# Autodesk Inventor assembly: potmeter
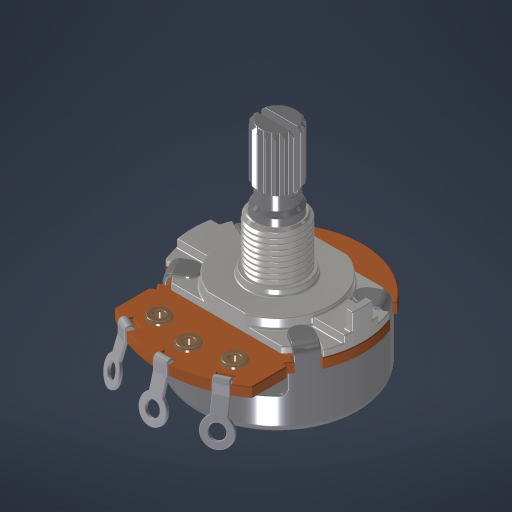
[picture p0: Inventor's stored thumbnail of the model, 512x512]
Saved by Autodesk Inventor 2023 (Build 270158000, 158)
## iProperties
Created: 2015-06-22
Part Number: potmeter
Document SubType Name: Assembly
Designer: Peter Mulkers
Author: Peter Mulkers
## Documents named in this file (10)
- D:\Folder Instalacyjny\GitHub Pliki\HOTAS\Inventor\Pot\potmeter.iam
- D:\Folder Instalacyjny\GitHub Pliki\HOTAS\Inventor\Pot\base.ipt
- D:\Folder Instalacyjny\GitHub Pliki\HOTAS\Inventor\Pot\casing.ipt
- D:\Folder Instalacyjny\GitHub Pliki\HOTAS\Inventor\Pot\revet.ipt
- D:\Folder Instalacyjny\GitHub Pliki\HOTAS\Inventor\Pot\bushing.ipt
- D:\Folder Instalacyjny\GitHub Pliki\HOTAS\Inventor\Pot\carbonpath.ipt
- D:\Folder Instalacyjny\GitHub Pliki\HOTAS\Inventor\Pot\carbon.ipt
- D:\Folder Instalacyjny\GitHub Pliki\HOTAS\Inventor\Pot\carbonpath m.ipt
- D:\Folder Instalacyjny\GitHub Pliki\HOTAS\Inventor\Pot\connector.ipt
- D:\Folder Instalacyjny\GitHub Pliki\HOTAS\Inventor\Pot\shaft.ipt
## Components (13 placed, 9 different names)
1. base:1 — Mate:1, Flush:1, Flush:2, Mate:2, Mate:3, Mate:4, Mate:5, Mate:6, Mate:7, Mate:8, Mate:9, Mate:10, Mate:11, Mate:13, Mate:17, Mate:19, Mate:21
2. casing:1 — Mate:1, Flush:3, Flush:4
3. revet:1 — Mate:2, Mate:5, Mate:18
4. revet:2 — Mate:3, Mate:6, Mate:14, Mate:16
5. revet:3 — Mate:4, Mate:7, Mate:20
6. bushing:1 — Mate:8, Mate:9, Mate:10, Mate:22
7. carbonpath:1 — Mate:11, Flush:5, Flush:6, Mate:12
8. carbon:1 — Mate:12, Flush:7, Flush:8
9. carbonpath m:1 — Mate:13, Mate:14, Flush:9, Mate:15
10. connector:1 — Mate:15, Mate:16, Flush:10
11. connector:2 — Mate:17, Mate:18, Angle:1
12. connector:3 — Mate:19, Mate:20, Angle:2
13. shaft:1 — Mate:21, Mate:22
## Relationships (34: Mate 22, Flush 10, Angle 2)
- Mate:1: base:1 ↔ casing:1
- Flush:1: base:1
- Flush:2: base:1
- Flush:3: casing:1
- Flush:4: casing:1
- Mate:2: base:1 ↔ revet:1
- Mate:3: base:1 ↔ revet:2
- Mate:4: base:1 ↔ revet:3
- Mate:5: base:1 ↔ revet:1
- Mate:6: base:1 ↔ revet:2
- Mate:7: base:1 ↔ revet:3
- Mate:8: base:1 ↔ bushing:1
- Mate:9: base:1 ↔ bushing:1
- Mate:10: base:1 ↔ bushing:1
- Mate:11: base:1 ↔ carbonpath:1
- Flush:5: carbonpath:1
- Flush:6: carbonpath:1
- Mate:12: carbonpath:1 ↔ carbon:1
- Flush:7: carbon:1
- Flush:8: carbon:1
- Mate:13: base:1 ↔ carbonpath m:1
- Mate:14: revet:2 ↔ carbonpath m:1
- Flush:9: carbonpath m:1
- Mate:15: carbonpath m:1 ↔ connector:1
- Mate:16: revet:2 ↔ connector:1
- Flush:10: connector:1
- Mate:17: base:1 ↔ connector:2
- Mate:18: revet:1 ↔ connector:2
- Angle:1 (25 deg): connector:2
- Mate:19: base:1 ↔ connector:3
- Mate:20: revet:3 ↔ connector:3
- Angle:2 (25 deg): connector:3
- Mate:21: base:1 ↔ shaft:1
- Mate:22: bushing:1 ↔ shaft:1
